# Autodesk Inventor assembly: robot_complet
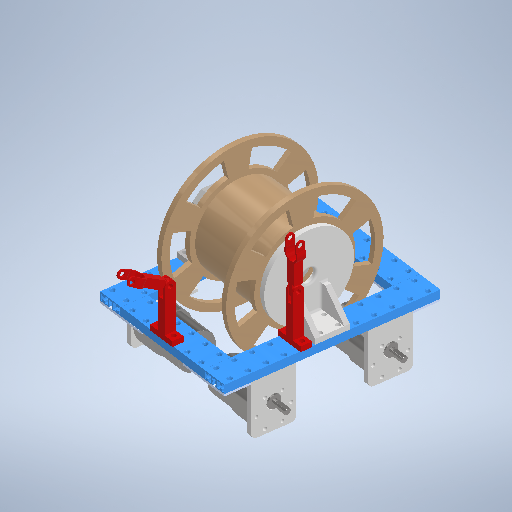
[picture p0: Inventor's stored thumbnail of the model, 512x512]
Saved by Autodesk Inventor 2025.3 (Build 293356000, 356)
## iProperties
Created: 2025-05-08
Part Number: robot_complet
Document SubType Name: Assembly
Designer: karle
Author: karle
## iProperties of the stored document Modelcraft RB350030-0A101R.ipt
Created: 2025-05-08
Part Number: Modelcraft RB350030-0A101R
Material: 1.0037 (S235JR)
Document SubType Name: Modeling
Designer: virgi
Density: 7.8 g/cm^3
Appearance: Vorgabe
Sending System: SOLIDWORKS 2019
last saved by: Kevin
Author: virgi
## iProperties of the stored document 4_03_pied_passage_tuyau v2.ipt
Created: 2025-05-04
Part Number: 4_03_pied_passage_tuyau v2
Material: Generic
Document SubType Name: Modeling
Designer: Diogo
Density: 1 g/cm^3
Appearance: Vorgabe
Sending System: Autodesk Inventor 2026
Author: Diogo
## iProperties of the stored document 01_ASM_Chassis_proto.iam
Created: 2025-04-30
Part Number: 01_ASM_Chassis_proto
Document SubType Name: Assembly
Designer: AdminForWorker
Sending System: Autodesk Inventor 2026
Title: 01_ASM_Chassis_proto v1
Author: AdminForWorker
## iProperties of the stored document support_de_maintient_incline2_tuyau.ipt
Created: 2025-05-04
Part Number: support_de_maintient_incline2_tuyau
Material: Generic
Document SubType Name: Modeling
Designer: virgi
Density: 1 g/cm^3
Appearance: Vorgabe
Sending System: Autodesk Inventor 2026
Author: virgi
## iProperties of the stored document 01_1_Plaque_bleue_3x6 v1.ipt
Created: 2025-04-30
Part Number: Default
Material: Generic
Description: Unknown
Document SubType Name: Modeling
Designer: AdminForWorker
Density: 1 g/cm^3
Appearance: Vorgabe
Sending System: Autodesk Inventor 2026
Title: 01_1_Plaque_bleue_3x6 v1
Author: AdminForWorker
## iProperties of the stored document 4_1_pied_avec_axe v7.ipt
Created: 2025-05-01
Part Number: 4_1_pied_avec_axe
Material: Generic
Document SubType Name: Modeling
Designer: AdminForWorker
Density: 1 g/cm^3
Appearance: Vorgabe
Sending System: Autodesk Inventor 2026
Title: 4_1_pied_avec_axe v7
Author: AdminForWorker
## iProperties of the stored document 01_3_Profilés_bleus_192mm v1.ipt
Created: 2025-04-30
Part Number: Beam 0824-192
Material: Generic
Description: Unknown
Document SubType Name: Modeling
Designer: AdminForWorker
Density: 1 g/cm^3
Appearance: Vorgabe
Sending System: Autodesk Inventor 2026
Title: 01_3_Profilés_bleus_192mm v1
Author: AdminForWorker
## iProperties of the stored document 4_04_asm_Bobine.iam
Created: 2025-05-01
Part Number: 4_04_asm_Bobine
Document SubType Name: Assembly
Designer: Diogo
Sending System: Autodesk Inventor 2026
Author: Diogo
## iProperties of the stored document 01_2_Profilés_bleus_96mm v1.ipt
Created: 2025-04-30
Part Number: Beam 0824-96
Material: Generic
Description: Unknown
Document SubType Name: Modeling
Designer: AdminForWorker
Density: 1 g/cm^3
Appearance: Vorgabe
Sending System: Autodesk Inventor 2026
Title: 01_2_Profilés_bleus_96mm v1
Author: AdminForWorker
## iProperties of the stored document support_de_maintient_incline_tuyau.ipt
Created: 2025-05-04
Part Number: support_de_maintient_incline_tuyau
Material: Generic
Document SubType Name: Modeling
Designer: virgi
Density: 1 g/cm^3
Appearance: Vorgabe
Sending System: Autodesk Inventor 2026
Author: virgi
## iProperties of the stored document supports_moteurs_petit_robot_v1.ipt
Created: 2025-05-02
Part Number: supports_moteurs_petit_robot_v1
Material: Generic
Document SubType Name: Modeling
Designer: virgi
Density: 1 g/cm^3
Appearance: Vorgabe
Sending System: Autodesk Inventor 2026
Author: virgi
## iProperties of the stored document ASM_petit_Robot.iam
Created: 2025-05-02
Part Number: ASM_petit_Robot
Document SubType Name: Assembly
Designer: virgi
Sending System: Autodesk Inventor 2026
Author: virgi
## iProperties of the stored document 4_02_Bobine v3.ipt
Created: 2025-05-01
Part Number: 4_02_Bobine
Material: Generic
Document SubType Name: Modeling
Designer: AdminForWorker
Density: 1 g/cm^3
Appearance: Vorgabe
Sending System: Autodesk Inventor 2026
Title: 4_02_Bobine v3
Author: AdminForWorker
## Documents named in this file (28)
- **C:\Users\karle\OneDrive - HESSO\P2511_Dossier_partage_RVEZ\01_Robot\0101_CAO\robot_complet.iam*LocalDocs*xAaaaazbaAaaaaaaaAaaaqdrwDd*Modelcraft RB350030-0A101R.ipt
- **C:\Users\karle\OneDrive - HESSO\P2511_Dossier_partage_RVEZ\01_Robot\0101_CAO\robot_complet.iam*LocalDocs*xAaaaajdaAaaaaaaaAaaaaylkUg*4_03_pied_passage_tuyau v2.ipt
- **C:\Users\karle\OneDrive - HESSO\P2511_Dossier_partage_RVEZ\01_Robot\0101_CAO\robot_complet.iam*LocalDocs*xAaaaa4caAaaaaaaaAaaaayqa0f*01_ASM_Chassis_proto.iam
- **C:\Users\karle\OneDrive - HESSO\P2511_Dossier_partage_RVEZ\01_Robot\0101_CAO\robot_complet.iam*LocalDocs*xAaaaafcaAaaaaaaaAaaaqhvs1d*01_3_Profilés_bleus_192mm v1.ipt
- **C:\Users\karle\OneDrive - HESSO\P2511_Dossier_partage_RVEZ\01_Robot\0101_CAO\robot_complet.iam*LocalDocs*xAaaaa1caAaaaaaaaAaaaach22f*01_1_Plaque_bleue_3x6 v1.ipt
- **C:\Users\karle\OneDrive - HESSO\P2511_Dossier_partage_RVEZ\01_Robot\0101_CAO\robot_complet.iam*LocalDocs*xAaaaayaaAaaaaaaaAaaaqy2mHc*01_2_Profilés_bleus_96mm v1.ipt
- **C:\Users\karle\OneDrive - HESSO\P2511_Dossier_partage_RVEZ\01_Robot\0101_CAO\robot_complet.iam*LocalDocs*xAaaaa3daAaaaaaaaAaaaqrrwGf*support_de_maintient_incline2_tuyau.ipt
- **C:\Users\karle\OneDrive - HESSO\P2511_Dossier_partage_RVEZ\01_Robot\0101_CAO\robot_complet.iam*LocalDocs*xAaaaa5daAaaaaaaaAaaaanbyAc*4_1_pied_avec_axe v7.ipt
- **C:\Users\karle\OneDrive - HESSO\P2511_Dossier_partage_RVEZ\01_Robot\0101_CAO\robot_complet.iam*LocalDocs*xAaaaaxaaAaaaaaaaAaaaagig2c*4_04_asm_Bobine.iam
- **C:\Users\karle\OneDrive - HESSO\P2511_Dossier_partage_RVEZ\01_Robot\0101_CAO\robot_complet.iam*LocalDocs*xAaaaqocaAaaaaaaaAaaaqyxc1c*4_02_Bobine v3.ipt
- **C:\Users\karle\OneDrive - HESSO\P2511_Dossier_partage_RVEZ\01_Robot\0101_CAO\robot_complet.iam*LocalDocs*xAaaaqocaAaaaaaaaAaaaqewgYc*support_de_maintient_incline_tuyau.ipt
- **C:\Users\karle\OneDrive - HESSO\P2511_Dossier_partage_RVEZ\01_Robot\0101_CAO\robot_complet.iam*LocalDocs*xAaaaqadaAaaaaaaaAaaaqvkvNf*supports_moteurs_petit_robot_v1.ipt
- **C:\Users\karle\OneDrive - HESSO\P2511_Dossier_partage_RVEZ\01_Robot\0101_CAO\robot_complet.iam*LocalDocs*xAaaaqldaAaaaaaaaAaaaql3yCg*ASM_petit_Robot.iam
- C:\Users\karle\OneDrive - HESSO\P2511_Dossier_partage_RVEZ\01_Robot\0101_CAO\robot_complet.iam
- C:\Users\karle\OneDrive - HESSO\P2511_Dossier_partage_RVEZ\01_Robot\0101_CAO\ASM_grand_Robot.iam
- C:\Users\karle\OneDrive - HESSO\P2511_Dossier_partage_RVEZ\01_Robot\0101_CAO\ASM_petit_Robot.iam
- C:\Users\karle\OneDrive - HESSO\P2511_Dossier_partage_RVEZ\01_Robot\0101_CAO\0_Châssis\01_Petit Châssis\01_1_Plaque_bleue_3x6 v1.ipt
- C:\Users\karle\OneDrive - HESSO\P2511_Dossier_partage_RVEZ\01_Robot\0101_CAO\0_Châssis\01_Petit Châssis\01_2_Profilés_bleus_96mm v1.ipt
- C:\Users\karle\OneDrive - HESSO\P2511_Dossier_partage_RVEZ\01_Robot\0101_CAO\0_Châssis\01_Petit Châssis\01_3_Profilés_bleus_192mm v1.ipt
- C:\Users\karle\OneDrive - HESSO\P2511_Dossier_partage_RVEZ\01_Robot\0101_CAO\0_Châssis\01_Petit Châssis\01_ASM_Chassis_proto.iam
- C:\Users\karle\OneDrive - HESSO\P2511_Dossier_partage_RVEZ\01_Robot\0101_CAO\4_Bobine\4_02_Bobine v3.ipt
- C:\Users\karle\OneDrive - HESSO\P2511_Dossier_partage_RVEZ\01_Robot\0101_CAO\4_Bobine\4_03_pied_passage_tuyau v2.ipt
- C:\Users\karle\OneDrive - HESSO\P2511_Dossier_partage_RVEZ\01_Robot\0101_CAO\4_Bobine\4_04_asm_Bobine.iam
- C:\Users\karle\OneDrive - HESSO\P2511_Dossier_partage_RVEZ\01_Robot\0101_CAO\4_Bobine\4_1_pied_avec_axe v7.ipt
- C:\Users\karle\OneDrive - HESSO\P2511_Dossier_partage_RVEZ\01_Robot\0101_CAO\Moteur\Modelcraft RB350030-0A101R\Modelcraft RB350030-0A101R\Modelcraft RB350030-0A101R.ipt
- C:\Users\karle\OneDrive - HESSO\P2511_Dossier_partage_RVEZ\01_Robot\0101_CAO\0_Châssis\01_Petit Châssis\supports_moteurs_petit_robot_v1.ipt
- C:\Users\karle\OneDrive - HESSO\P2511_Dossier_partage_RVEZ\01_Robot\0101_CAO\4_Bobine\support_de_maintient_incline2_tuyau.ipt
- C:\Users\karle\OneDrive - HESSO\P2511_Dossier_partage_RVEZ\01_Robot\0101_CAO\4_Bobine\support_de_maintient_incline_tuyau.ipt
## Components (2 placed, 2 different names)
1. ASM_grand_Robot:1 [sub-assembly] — Passend:1, Passend:2, Passend:3
2. ASM_petit_Robot:1 [sub-assembly] — Passend:1, Passend:2, Passend:3
## Relationships (3: Mate 3)
- Passend:1 [Mate]: ASM_grand_Robot:1 ↔ ASM_petit_Robot:1
- Passend:2 [Mate] (20 mm): ASM_grand_Robot:1 ↔ ASM_petit_Robot:1
- Passend:3 [Mate]: ASM_grand_Robot:1 ↔ ASM_petit_Robot:1
